# Autodesk Inventor assembly: as_sub
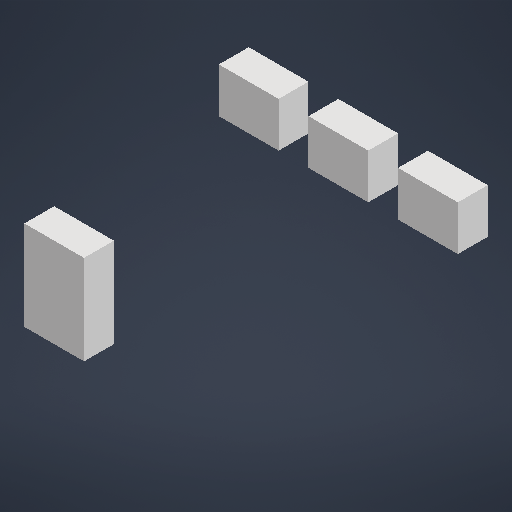
[picture p0: Inventor's stored thumbnail of the model, 512x512]
Saved by Autodesk Inventor 2027 (Build 310192060, 192F)
## iProperties
Created: 2026-10-20
Part Number: as_sub
Document SubType Name: Assembly
Designer: vmiguel
Author: vmiguel
## Documents named in this file (3)
- C:\Users\vmiguel\git\inventor-interface\writer\fixtures\spec\as_sub.iam
- C:\Users\vmiguel\git\inventor-interface\writer\fixtures\spec\ex_rect20.ipt
- C:\Users\vmiguel\git\inventor-interface\writer\fixtures\spec\as_jrot.iam
## Components (4 placed, 2 different names)
1. as_jrot:1 [sub-assembly]
2. ex_rect20:1
3. ex_rect20:2
4. ex_rect20:3
## Component patterns: (3 elements, first: ex_rect20:1)
